# Autodesk Inventor assembly: roboassy
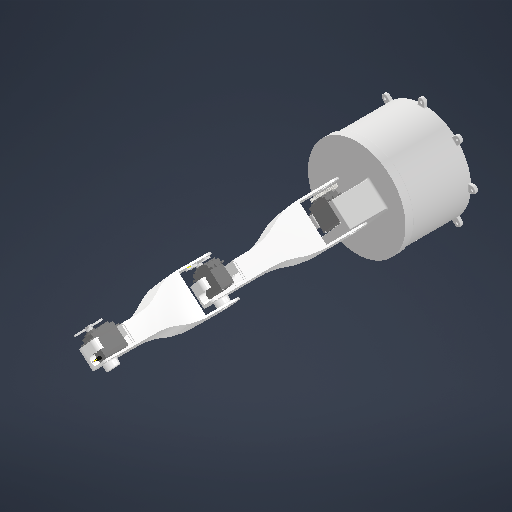
[picture p0: Inventor's stored thumbnail of the model, 512x512]
Saved by Autodesk Inventor 2027.1 (Build 311270010, 270A)
## iProperties
Created: 2025-10-01
Part Number: roboassy
Document SubType Name: Assembly
Designer: amon-
Author: amon-
## Documents named in this file (6)
- C:\Users\nasra\Downloads\Arduino\KasiVarsi\.ipt .iam .step -tiedostot\roboassy.iam
- C:\Users\nasra\Downloads\Arduino\KasiVarsi\.ipt .iam .step -tiedostot\jalusta_kokoonpano.iam
- C:\Users\nasra\Downloads\Arduino\KasiVarsi\.ipt .iam .step -tiedostot\arm1.ipt
- C:\Users\nasra\Downloads\Arduino\KasiVarsi\.ipt .iam .step -tiedostot\mg996R_v2.ipt
- C:\Users\nasra\Downloads\Arduino\KasiVarsi\.ipt .iam .step -tiedostot\mg996_arm_4pad.ipt
- C:\Users\nasra\Downloads\Arduino\KasiVarsi\Omat\VaihteetKokonpano\Design Accelerator\Spur Gears1.iam
## Components (8 placed, 5 different names)
1. jalusta_kokoonpano:1 [sub-assembly] — Insert:1, Insert:3
2. arm1:1 — Insert:1, Insert:2
3. mg996R_v2:1 — Rotational:4
4. mg996_arm_4pad:1 — Rotational:4, Rotational:6
5. arm1:2 — Rotational:6, Insert:2
6. mg996R_v2:2
7. mg996_arm_4pad:2
8. Spur Gears:1 [sub-assembly] — Insert:3
## Relationships (9: RevoluteJoint 3, Mate 3, Insert 3)
- Rotational:4 [RevoluteJoint]: mg996R_v2:1 ↔ mg996_arm_4pad:1
- [Mate]: arm1:2 ↔ mg996R_v2:2
- [Mate]: arm1:2 ↔ mg996R_v2:2
- [Mate]: arm1:2 ↔ mg996R_v2:2
- [RevoluteJoint]: mg996R_v2:2 ↔ mg996_arm_4pad:2
- Rotational:6 [RevoluteJoint]: mg996_arm_4pad:1 ↔ arm1:2
- Insert:1: jalusta_kokoonpano:1 ↔ arm1:1
- Insert:2: arm1:1 ↔ arm1:2
- Insert:3: jalusta_kokoonpano:1 ↔ Spur Gears:1
## Named parameters: d7_d2 = 0 mm, d8_d3 = 0 mm, d9_d4 = 0 mm, d10_d5 = 0 mm, d11_d6 = 1.240409 deg
